# Autodesk Inventor assembly: Membrane-flange
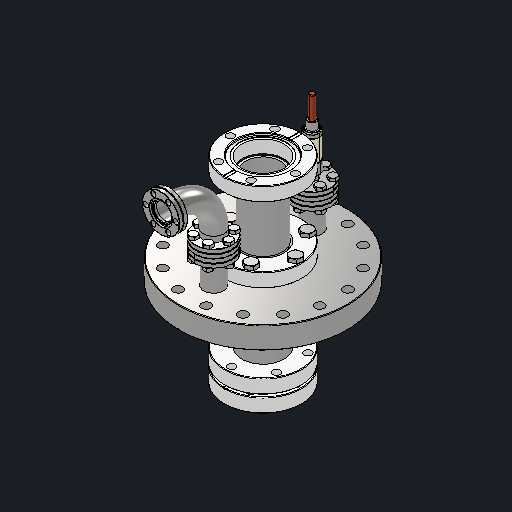
[picture p0: Inventor's stored thumbnail of the model, 512x512]
Saved by Autodesk Inventor 2027.1 (Build 311270010, 270A)
## iProperties
Created: 2019-10-17
Part Number: Membrane-flange
Document SubType Name: Assembly
Designer: kuzmin
Mass: 4363.93 g
Surface Area: 2140.49 cm^2
Volume: 545.917 cm^3
Density: 7.99376 g/cm^3
Author: kuzmin
## iProperties of the stored document MemberDocs/xAaaaqkbaAaaaaaaaAaaaanrgXc
Created: 2019-10-17
Part Number: Membrane-flange
Document SubType Name: Assembly
Designer: kuzmin
Mass: 4363.93 g
Surface Area: 2140.49 cm^2
Volume: 545.917 cm^3
Density: 7.99376 g/cm^3
Author: kuzmin
## Documents named in this file (45)
- C:\Users\queezz\Dropbox\Drawings\pihti-cad\Miura-membrane-experiments\Membrane-flange-V2.iam
- C:\Users\queez\Dropbox\Drawings\Leprecon\Membrane_Flange\Membrane-welded.iam
- C:\Users\queez\Dropbox\Drawings\Leprecon\Membrane_Flange\152-double-70.ipt
- C:\Users\queez\Dropbox\Drawings\Leprecon\ICFs\Gasket_70.ipt
- C:\Users\queez\Dropbox\Drawings\Leprecon\ICFs\ICF-70-nipple-VUV.iam
- C:\Users\queez\Dropbox\Drawings\Leprecon\StandarComponents\ISO 4017 - M6 x 25 - ISO.ipt
- C:\Users\queez\Dropbox\Drawings\Leprecon\ICFs\Gasket_152.ipt
- C:\Users\queez\Dropbox\Drawings\Leprecon\ICFs\Gasket_34.ipt
- C:\Users\queez\Dropbox\Drawings\Leprecon\Downloaded\cosmotec-feed\C15K110A1CUM5N.iam
- C:\Users\queez\Dropbox\Drawings\Leprecon\Downloaded\cosmo-34L\ICF34EL.iam
- C:\Users\queez\Dropbox\Drawings\Leprecon\StandarComponents\BS 3692 - M4 x 18(1).ipt
- C:\Users\queez\Dropbox\Drawings\Leprecon\Membrane_Flange\34-port1.ipt
- C:\Users\queez\Dropbox\Drawings\Leprecon\StandarComponents\AS 1112 - M4  Type 5.ipt
- C:\Users\queez\Dropbox\Drawings\Leprecon\ICFs\ICF70to34.ipt
- C:\Users\queez\Dropbox\Drawings\Leprecon\Membrane_Flange\70-nipple-short.iam
- C:\Users\queez\Dropbox\Drawings\Leprecon\Membrane_Flange\70-nipple-flange.ipt
- C:\Users\queezz\Dropbox\Drawings\pihti-cad\Miura-membrane-experiments\Membrane-welded.iam
- C:\Users\queezz\Dropbox\Drawings\pihti-cad\Miura-membrane-experiments\152-double-70.ipt
- C:\Users\queezz\Dropbox\Drawings\pihti-cad\Miura-membrane-experiments\components\Gasket_70.ipt
- C:\Users\queezz\Dropbox\Drawings\pihti-cad\Miura-membrane-experiments\components\ICF-70-nipple-VUV.iam
- C:\Users\queezz\Dropbox\Drawings\pihti-cad\Miura-membrane-experiments\components\ISO 4017 - M6 x 25 - ISO.ipt
- C:\Users\queezz\Dropbox\Drawings\pihti-cad\Miura-membrane-experiments\components\Gasket_152.ipt
- C:\Users\queezz\Dropbox\Drawings\pihti-cad\Miura-membrane-experiments\components\Gasket_34.ipt
- C:\Users\queezz\Dropbox\Drawings\pihti-cad\Miura-membrane-experiments\components\C15K110A1CUM5N.iam
- C:\Users\queezz\Dropbox\Drawings\pihti-cad\Miura-membrane-experiments\components\ICF34EL.iam
- C:\Users\queezz\Dropbox\Drawings\pihti-cad\Miura-membrane-experiments\components\BS 3692 - M4 x 18(1).ipt
- C:\Users\queezz\Dropbox\Drawings\pihti-cad\Miura-membrane-experiments\34-port1.ipt
- C:\Users\queezz\Dropbox\Drawings\pihti-cad\Miura-membrane-experiments\components\AS 1112 - M4  Type 5.ipt
- C:\Users\queezz\Dropbox\Drawings\pihti-cad\Miura-membrane-experiments\components\ICF70to34.ipt
- C:\Users\queezz\Dropbox\Drawings\pihti-cad\Miura-membrane-experiments\70-nipple-short.iam
- C:\Users\queezz\Dropbox\Drawings\pihti-cad\Miura-membrane-experiments\70-nipple-flange.ipt
- C:\Users\mkse\Dropbox\研究室\Leprecon\Membrane_Flange\Membrane-welded.iam
- C:\Users\mkse\Dropbox\研究室\Leprecon\Membrane_Flange\152-double-70.ipt
- C:\Users\mkse\Dropbox\研究室\Leprecon\ICFs\Gasket_70.ipt
- C:\Users\mkse\Dropbox\研究室\Leprecon\ICFs\ICF-70-nipple-VUV.iam
- C:\Users\mkse\Dropbox\研究室\Leprecon\StandarComponents\ISO 4017 - M6 x 25 - ISO.ipt
- C:\Users\mkse\Dropbox\研究室\Leprecon\ICFs\Gasket_152.ipt
- C:\Users\mkse\Dropbox\研究室\Leprecon\ICFs\Gasket_34.ipt
- C:\Users\mkse\Dropbox\研究室\Leprecon\Downloaded\cosmotec-feed\C15K110A1CUM5N.iam
- C:\Users\mkse\Dropbox\研究室\Leprecon\Downloaded\cosmo-34L\ICF34EL.iam
- C:\Users\mkse\Dropbox\研究室\Leprecon\StandarComponents\BS 3692 - M4 x 18(1).ipt
- C:\Users\mkse\Dropbox\研究室\Leprecon\Membrane_Flange\34-port1.ipt
- C:\Users\mkse\Dropbox\研究室\Leprecon\StandarComponents\AS 1112 - M4  Type 5.ipt
- C:\Users\mkse\Dropbox\研究室\Leprecon\ICFs\ICF70to34.ipt
- C:\Users\shora\Dropbox\Leprecon\Membrane_Flange\Membrane-flange-V2.iam
## Components (51 placed, 15 different names)
1. Membrane-welded:1 [sub-assembly] — 挿入:33, 挿入:34
2. 152-double-70:1 — Rotational:1, Flush:1, Mate:11, Mate:12, Rotational:5, Mate:15, Rotational:8, Rigid:5, Rotational:27
3. Gasket_70:1 — Rotational:1, 挿入:17, 挿入:26
4. ICF-70-nipple-VUV:1 [sub-assembly] — Mate:15, Insert:1, Insert:2, Insert:3, Insert:4, Insert:5, Insert:6, 挿入:18, 挿入:25
5. Gasket_70:2 — Rotational:5, 挿入:18, 挿入:25
6. Gasket_152:1 — Rotational:8
7. Gasket_34:1 — Rotational:12, Rotational:15
8. Gasket_34:2 — Rotational:11
9. C15K110A1CUM5N:1 [sub-assembly] — Rotational:11, Insert:13, Insert:14, Insert:15, Rigid:2, Rigid:3, Rigid:4, Mate:17, Rotational:28
10. ICF34EL:1 [sub-assembly] — Rotational:12, Mate:18, Rigid:6, Rigid:7, Rigid:8, Rigid:9, Rigid:10, Rigid:11
11. 34-port1:1 — Mate:17, Insert:16, Rotational:16, Rotational:17, Rotational:18, Rotational:19, Rotational:20, Rotational:27, Rotational:28
12. 34-port1:2 — Rigid:5, Rotational:15, Mate:18, Rotational:21, Rotational:22, Rotational:23, Rotational:24, Rotational:25, Rotational:26
13. ICF70to34:1 — 挿入:17, 挿入:19, 挿入:20, 挿入:21, 挿入:22, 挿入:23, 挿入:24
14. 70-nipple-short:1 [sub-assembly] — 挿入:26, 挿入:27, 挿入:28, 挿入:29, 挿入:30, 挿入:31, 挿入:32, 挿入:33
15. 70-nipple-flange:1 — 挿入:34
16. BS 3692 Hexagon Head Screw - Metric M4 x 18:7 — Rigid:9
17. BS 3692 Hexagon Head Screw - Metric M4 x 18:8 — Rigid:11
18. BS 3692 Hexagon Head Screw - Metric M4 x 18:9 — Rigid:8
19. BS 3692 Hexagon Head Screw - Metric M4 x 18:10 — Rigid:7
20. BS 3692 Hexagon Head Screw - Metric M4 x 18:11 — Rigid:6
21. BS 3692 Hexagon Head Screw - Metric M4 x 18:12 — Rigid:10
22. AS 1112 (2) - Metric M4  Type 5:1 — Insert:16
23. AS 1112 (2) - Metric M4  Type 5:2 — Rotational:17
24. AS 1112 (2) - Metric M4  Type 5:3 — Rotational:16
25. AS 1112 (2) - Metric M4  Type 5:4 — Rotational:19
26. AS 1112 (2) - Metric M4  Type 5:5 — Rotational:20
27. AS 1112 (2) - Metric M4  Type 5:6 — Rotational:18
28. AS 1112 (2) - Metric M4  Type 5:7 — Rotational:26
29. AS 1112 (2) - Metric M4  Type 5:8 — Rotational:23
30. AS 1112 (2) - Metric M4  Type 5:9 — Rotational:24
31. AS 1112 (2) - Metric M4  Type 5:10 — Rotational:22
32. AS 1112 (2) - Metric M4  Type 5:11 — Rotational:21
33. AS 1112 (2) - Metric M4  Type 5:12 — Rotational:25
34. BS 3692 Hexagon Head Screw - Metric M4 x 18:1 — Insert:13
35. BS 3692 Hexagon Head Screw - Metric M4 x 18:2 — Insert:14
36. BS 3692 Hexagon Head Screw - Metric M4 x 18:3 — Insert:15
37. BS 3692 Hexagon Head Screw - Metric M4 x 18:4 — Rigid:4
38. BS 3692 Hexagon Head Screw - Metric M4 x 18:5 — Rigid:3
39. BS 3692 Hexagon Head Screw - Metric M4 x 18:6 — Rigid:2
40. ISO 4017 M6 x 25:1 — Insert:1
41. ISO 4017 M6 x 25:2 — Insert:2
42. ISO 4017 M6 x 25:3 — Insert:3
43. ISO 4017 M6 x 25:4 — Insert:4
44. ISO 4017 M6 x 25:5 — Insert:5
45. ISO 4017 M6 x 25:6 — Insert:6
46. ISO 4017 M6 x 25:7 — 挿入:22, 挿入:30
47. ISO 4017 M6 x 25:8 — 挿入:21, 挿入:29
48. ISO 4017 M6 x 25:9 — 挿入:20, 挿入:28
49. ISO 4017 M6 x 25:10 — 挿入:19, 挿入:27
50. ISO 4017 M6 x 25:11 — 挿入:24, 挿入:32
51. ISO 4017 M6 x 25:12 — 挿入:23, 挿入:31
## Relationships (63: Insert 28, RevoluteJoint 19, WeldJoint 10, Mate 5, Flush 1)
- Rotational:1 [RevoluteJoint]: 152-double-70:1 ↔ Gasket_70:1
- Flush:1: 152-double-70:1
- Mate:11: 152-double-70:1
- Mate:12: 152-double-70:1
- Rotational:5 [RevoluteJoint]: 152-double-70:1 ↔ Gasket_70:2
- Mate:15: 152-double-70:1 ↔ ICF-70-nipple-VUV:1
- Insert:1: ICF-70-nipple-VUV:1 ↔ ISO 4017 M6 x 25:1
- Insert:2: ICF-70-nipple-VUV:1 ↔ ISO 4017 M6 x 25:2
- Insert:3: ICF-70-nipple-VUV:1 ↔ ISO 4017 M6 x 25:3
- Insert:4: ICF-70-nipple-VUV:1 ↔ ISO 4017 M6 x 25:4
- Insert:5: ICF-70-nipple-VUV:1 ↔ ISO 4017 M6 x 25:5
- Insert:6: ICF-70-nipple-VUV:1 ↔ ISO 4017 M6 x 25:6
- Rotational:8 [RevoluteJoint]: 152-double-70:1 ↔ Gasket_152:1
- Rotational:11 [RevoluteJoint]: Gasket_34:2 ↔ C15K110A1CUM5N:1
- Rotational:12 [RevoluteJoint]: Gasket_34:1 ↔ ICF34EL:1
- Insert:13: C15K110A1CUM5N:1 ↔ BS 3692 Hexagon Head Screw - Metric M4 x 18:1
- Insert:14: C15K110A1CUM5N:1 ↔ BS 3692 Hexagon Head Screw - Metric M4 x 18:2
- Insert:15: C15K110A1CUM5N:1 ↔ BS 3692 Hexagon Head Screw - Metric M4 x 18:3
- Rigid:2 [WeldJoint]: C15K110A1CUM5N:1 ↔ BS 3692 Hexagon Head Screw - Metric M4 x 18:6
- Rigid:3 [WeldJoint]: C15K110A1CUM5N:1 ↔ BS 3692 Hexagon Head Screw - Metric M4 x 18:5
- Rigid:4 [WeldJoint]: C15K110A1CUM5N:1 ↔ BS 3692 Hexagon Head Screw - Metric M4 x 18:4
- Rigid:5 [WeldJoint]: 152-double-70:1 ↔ 34-port1:2
- Mate:17: C15K110A1CUM5N:1 ↔ 34-port1:1
- Rotational:15 [RevoluteJoint]: Gasket_34:1 ↔ 34-port1:2
- Mate:18: ICF34EL:1 ↔ 34-port1:2
- Rigid:6 [WeldJoint]: ICF34EL:1 ↔ BS 3692 Hexagon Head Screw - Metric M4 x 18:11
- Rigid:7 [WeldJoint]: ICF34EL:1 ↔ BS 3692 Hexagon Head Screw - Metric M4 x 18:10
- Rigid:8 [WeldJoint]: ICF34EL:1 ↔ BS 3692 Hexagon Head Screw - Metric M4 x 18:9
- Rigid:9 [WeldJoint]: ICF34EL:1 ↔ BS 3692 Hexagon Head Screw - Metric M4 x 18:7
- Rigid:10 [WeldJoint]: ICF34EL:1 ↔ BS 3692 Hexagon Head Screw - Metric M4 x 18:12
- Rigid:11 [WeldJoint]: ICF34EL:1 ↔ BS 3692 Hexagon Head Screw - Metric M4 x 18:8
- Insert:16: 34-port1:1 ↔ AS 1112 (2) - Metric M4  Type 5:1
- Rotational:16 [RevoluteJoint]: 34-port1:1 ↔ AS 1112 (2) - Metric M4  Type 5:3
- Rotational:17 [RevoluteJoint]: 34-port1:1 ↔ AS 1112 (2) - Metric M4  Type 5:2
- Rotational:18 [RevoluteJoint]: 34-port1:1 ↔ AS 1112 (2) - Metric M4  Type 5:6
- Rotational:19 [RevoluteJoint]: 34-port1:1 ↔ AS 1112 (2) - Metric M4  Type 5:4
- Rotational:20 [RevoluteJoint]: 34-port1:1 ↔ AS 1112 (2) - Metric M4  Type 5:5
- Rotational:21 [RevoluteJoint]: 34-port1:2 ↔ AS 1112 (2) - Metric M4  Type 5:11
- Rotational:22 [RevoluteJoint]: 34-port1:2 ↔ AS 1112 (2) - Metric M4  Type 5:10
- Rotational:23 [RevoluteJoint]: 34-port1:2 ↔ AS 1112 (2) - Metric M4  Type 5:8
- Rotational:24 [RevoluteJoint]: 34-port1:2 ↔ AS 1112 (2) - Metric M4  Type 5:9
- Rotational:25 [RevoluteJoint]: 34-port1:2 ↔ AS 1112 (2) - Metric M4  Type 5:12
- Rotational:26 [RevoluteJoint]: 34-port1:2 ↔ AS 1112 (2) - Metric M4  Type 5:7
- Rotational:27 [RevoluteJoint]: 152-double-70:1 ↔ 34-port1:1
- Rotational:28 [RevoluteJoint]: C15K110A1CUM5N:1 ↔ 34-port1:1
- 挿入:17 [Insert]: Gasket_70:1 ↔ ICF70to34:1
- 挿入:18 [Insert]: ICF-70-nipple-VUV:1 ↔ Gasket_70:2
- 挿入:19 [Insert]: ICF70to34:1 ↔ ISO 4017 M6 x 25:10
- 挿入:20 [Insert]: ICF70to34:1 ↔ ISO 4017 M6 x 25:9
- 挿入:21 [Insert]: ICF70to34:1 ↔ ISO 4017 M6 x 25:8
- 挿入:22 [Insert]: ICF70to34:1 ↔ ISO 4017 M6 x 25:7
- 挿入:23 [Insert]: ICF70to34:1 ↔ ISO 4017 M6 x 25:12
- 挿入:24 [Insert]: ICF70to34:1 ↔ ISO 4017 M6 x 25:11
- 挿入:25 [Insert]: ICF-70-nipple-VUV:1 ↔ Gasket_70:2
- 挿入:26 [Insert]: Gasket_70:1 ↔ 70-nipple-short:1
- 挿入:27 [Insert]: 70-nipple-short:1 ↔ ISO 4017 M6 x 25:10
- 挿入:28 [Insert]: 70-nipple-short:1 ↔ ISO 4017 M6 x 25:9
- 挿入:29 [Insert]: 70-nipple-short:1 ↔ ISO 4017 M6 x 25:8
- 挿入:30 [Insert]: 70-nipple-short:1 ↔ ISO 4017 M6 x 25:7
- 挿入:31 [Insert]: 70-nipple-short:1 ↔ ISO 4017 M6 x 25:12
- 挿入:32 [Insert]: 70-nipple-short:1 ↔ ISO 4017 M6 x 25:11
- 挿入:33 [Insert]: Membrane-welded:1 ↔ 70-nipple-short:1
- 挿入:34 [Insert]: Membrane-welded:1 ↔ 70-nipple-flange:1
